# Autodesk Inventor assembly: snail_coffin_cavity
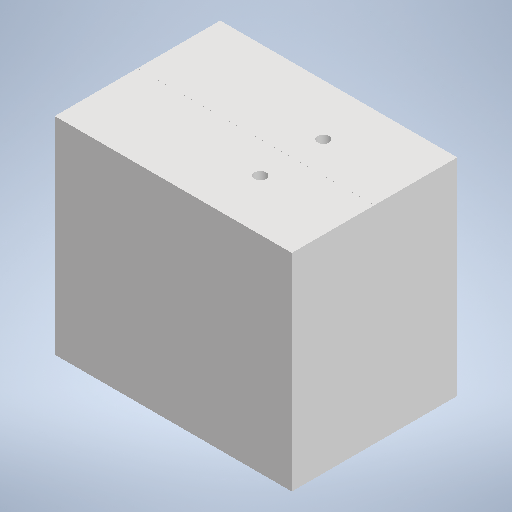
[picture p0: Inventor's stored thumbnail of the model, 512x512]
Saved by Autodesk Inventor 2025 (Build 290162010, 162A)
## iProperties
Created: 2024-06-10
Part Number: snail_coffin_cavity
Document SubType Name: Assembly
Designer: ajb
Author: ajb
## Documents named in this file (3)
- C:\andre\snail_coffin_cavity\inventor_files\snail_coffin_cavity.iam
- C:\andre\snail_coffin_cavity\inventor_files\snail_coffin_cavity_bottom.ipt
- C:\andre\snail_coffin_cavity\inventor_files\snail_coffin_cavity_top.ipt
## Components (2 placed, 2 different names)
1. snail_coffin_cavity_bottom:1 — Mate:1, Mate:2, Mate:3, Mate:4, Mate:5
2. snail_coffin_cavity_top:1 — Mate:1, Mate:2, Mate:3, Mate:4, Mate:5
## Relationships (5: Mate 5)
- Mate:1: snail_coffin_cavity_bottom:1 ↔ snail_coffin_cavity_top:1
- Mate:2: snail_coffin_cavity_bottom:1 ↔ snail_coffin_cavity_top:1
- Mate:3: snail_coffin_cavity_bottom:1 ↔ snail_coffin_cavity_top:1
- Mate:4: snail_coffin_cavity_bottom:1 ↔ snail_coffin_cavity_top:1
- Mate:5: snail_coffin_cavity_bottom:1 ↔ snail_coffin_cavity_top:1
## Named parameters: cavity_x = 32 mm, cavity_y = 9 mm, cavity_z = 32 mm, chip_length = 34.75 mm, chip_width = 7.5 mm, chip_thickness = 0.43 mm, chip_delta_x_neg = 2.25 mm, chip_delta_x_pos = 4.45 mm, chip_delta_y_neg = 0 mm, chip_delta_y_pos = 0.565 mm, theta = 56 deg, flux_loop_length = 8.105 mm, flux_loop_width = 1 mm, flux_loop_padding = 0.43 mm, sma_port_length = 8.75 mm, sma_port_diameter = 2.946 mm, seam_width = 1.2 mm, padding = 5 mm, flux_delta_x_neg = 0.05 mm, flux_delta_x_pos = 0.95 mm, chip_padding = 0.4 mm
